# Autodesk Inventor assembly: Assembly1
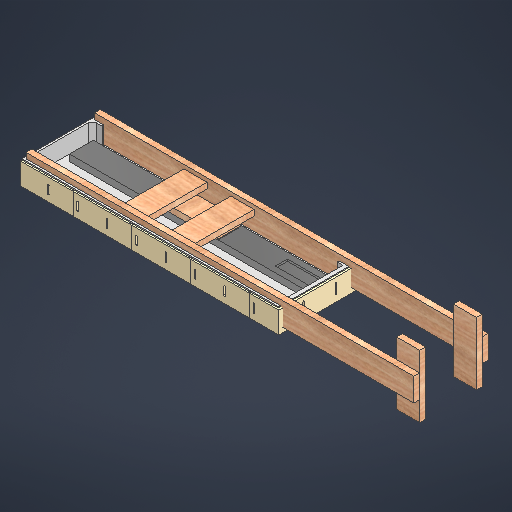
[picture p0: Inventor's stored thumbnail of the model, 512x512]
Saved by Autodesk Inventor 2027 (Build 310192060, 192F)
## iProperties
Created: 2026-10-12
Part Number: Assembly1
Document SubType Name: Assembly
Designer: Pablo
Author: Pablo
## Documents named in this file (6)
- C:\Users\Pablo\Documents\GitHub\Portfolio\content\ubibus\UBIBUS\Modelo3D_prototipo2\Assembly1.iam
- C:\Users\Pablo\Documents\GitHub\Portfolio\content\ubibus\UBIBUS\Modelo3D_prototipo2\Pantalla_v0.ipt
- C:\Users\Pablo\Documents\GitHub\Portfolio\content\ubibus\UBIBUS\Modelo3D_prototipo2\Pilar_sin_cortar_e15_v0.ipt
- C:\Users\Pablo\Documents\GitHub\Portfolio\content\ubibus\UBIBUS\Modelo3D_prototipo2\Carcasa_entera_v0.ipt
- C:\Users\Pablo\Documents\GitHub\Portfolio\content\ubibus\UBIBUS\Modelo3D_prototipo2\Transversal_e15_v0.ipt
- C:\Users\Pablo\Documents\GitHub\Portfolio\content\ubibus\UBIBUS\Modelo3D_prototipo2\Marco_exterior_v0.ipt
## Components (10 placed, 5 different names)
1. Pantalla_v0:1 — Mate:2, Mate:16, Mate:3, Mate:8, Mate:10, Mate:11, Mate:23
2. Carcasa_entera_v0:1 — Mate:2, Mate:16, Mate:3, Mate:4, Mate:5, Mate:15, Mate:14, Mate:13, Mate:12, Mate:17, Mate:18, Flush:1, Mate:24
3. Pilar_sin_cortar_e15_v0:1 — Mate:5, Mate:15, Mate:12, Mate:19, Flush:21, Flush:23
4. Pilar_sin_cortar_e15_v0:2 — Mate:4, Mate:14, Mate:13, Mate:6, Mate:7, Flush:3, Mate:21, Flush:24
5. Transversal_e15_v0:1 — Mate:6, Mate:10, Flush:2, Mate:9, Flush:25
6. Transversal_e15_v0:2 — Mate:7, Mate:11, Mate:22
7. Marco_exterior_v0:1 — Mate:17, Mate:18, Flush:1
8. Transversal_e15_v0:3 — Mate:8, Mate:9, Mate:22, Mate:23, Flush:25
9. Transversal_e15_v0:4 — Mate:19, Flush:21, Flush:23
10. Transversal_e15_v0:5 — Flush:3, Mate:21, Flush:24
## Relationships (29: Mate 22, Flush 7)
- Mate:2: Pantalla_v0:1 ↔ Carcasa_entera_v0:1
- Mate:16: Pantalla_v0:1 ↔ Carcasa_entera_v0:1
- Mate:3 (-20 mm): Pantalla_v0:1 ↔ Carcasa_entera_v0:1
- Mate:4: Carcasa_entera_v0:1 ↔ Pilar_sin_cortar_e15_v0:2
- Mate:5: Carcasa_entera_v0:1 ↔ Pilar_sin_cortar_e15_v0:1
- Mate:15: Carcasa_entera_v0:1 ↔ Pilar_sin_cortar_e15_v0:1
- Mate:14: Carcasa_entera_v0:1 ↔ Pilar_sin_cortar_e15_v0:2
- Mate:13: Carcasa_entera_v0:1 ↔ Pilar_sin_cortar_e15_v0:2
- Mate:12: Carcasa_entera_v0:1 ↔ Pilar_sin_cortar_e15_v0:1
- Mate:6: Pilar_sin_cortar_e15_v0:2 ↔ Transversal_e15_v0:1
- Mate:7: Pilar_sin_cortar_e15_v0:2 ↔ Transversal_e15_v0:2
- Mate:8: Pantalla_v0:1 ↔ Transversal_e15_v0:3
- Mate:9: Transversal_e15_v0:1 ↔ Transversal_e15_v0:3
- Mate:10: Pantalla_v0:1 ↔ Transversal_e15_v0:1
- Mate:11: Pantalla_v0:1 ↔ Transversal_e15_v0:2
- Mate:17: Carcasa_entera_v0:1 ↔ Marco_exterior_v0:1
- Mate:18 (4 mm): Carcasa_entera_v0:1 ↔ Marco_exterior_v0:1
- Flush:1: Carcasa_entera_v0:1 ↔ Marco_exterior_v0:1
- Flush:2 (50 mm): Transversal_e15_v0:1
- Mate:19: Pilar_sin_cortar_e15_v0:1 ↔ Transversal_e15_v0:4
- Flush:21: Pilar_sin_cortar_e15_v0:1 ↔ Transversal_e15_v0:4
- Flush:3: Pilar_sin_cortar_e15_v0:2 ↔ Transversal_e15_v0:5
- Mate:21: Pilar_sin_cortar_e15_v0:2 ↔ Transversal_e15_v0:5
- Flush:23 (50 mm): Pilar_sin_cortar_e15_v0:1 ↔ Transversal_e15_v0:4
- Flush:24 (-50 mm): Pilar_sin_cortar_e15_v0:2 ↔ Transversal_e15_v0:5
- Mate:22: Transversal_e15_v0:2 ↔ Transversal_e15_v0:3
- Mate:23: Pantalla_v0:1 ↔ Transversal_e15_v0:3
- Mate:24: Carcasa_entera_v0:1
- Flush:25 (10 mm): Transversal_e15_v0:1 ↔ Transversal_e15_v0:3
